# Autodesk Inventor assembly: drivetrain
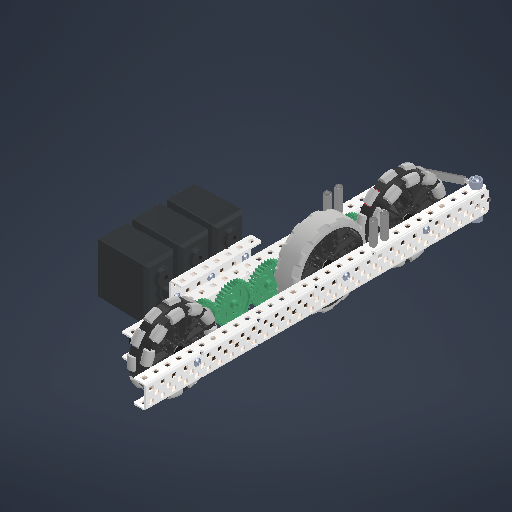
[picture p0: Inventor's stored thumbnail of the model, 512x512]
Saved by Autodesk Inventor 2026.2 (Build 302298000, 298)
## iProperties
Created: 2026-11-04
Part Number: drivetrain
Document SubType Name: Assembly
Designer: BuddyProject
Author: BuddyProject
## Documents named in this file (30)
- E:\593C-CAD-26-27\halfdrivetrain.iam
- E:\VEX-CAD-Inventor-main\Structure\C Channel\Aluminum 1x2x1\Alu C 1x2x1x25.ipt
- E:\VEX-CAD-Inventor-main\Motion\Wheels\Omni Wheel.iam
- E:\VEX-CAD-Inventor-main\Motion\Wheels\Omni Wheel\3.25 Omni AS, No Insert.iam
- E:\VEX-CAD-Inventor-main\Motion\HS Shaft Adapter Circle.ipt
- E:\VEX-CAD-Inventor-main\Motion\Gears\HS Gear.iam
- E:\VEX-CAD-Inventor-main\Motion\Gears\HS Gear\HS 48T Gear, No Insert.iam
- E:\VEX-CAD-Inventor-main\Motion\Wheels\Traction Wheel\3.25 Traction AS, No Insert.iam
- E:\VEX-CAD-Inventor-main\Motion\Wheels\Traction Wheel.iam
- E:\VEX-CAD-Inventor-main\Structure\C Channel\Aluminum 1x2x1\Alu C 1x2x1x30.ipt
- E:\593C-CAD-26-27\dtmotorsub.iam
- E:\VEX-CAD-Inventor-main\Structure\Standoff\Standoff 1.00.ipt
- D:\VEX-CAD-Inventor-main\Structure\Standoff.ipt
- E:\VEX-CAD-Inventor-main\Motion\Shaft LS\Bearing Flat - Shaved.ipt
- E:\593C-CAD-26-27\ModifiedComponents\Bearing Flat - ShavedCut.ipt
- E:\VEX-CAD-Inventor-main\Motion\Shaft LS\Bearing Flat.ipt
- E:\VEX-CAD-Inventor-main\Structure\Hardware\Screw Steel - Star\SScrew Star Threaded 2.500.ipt
- D:\VEX-CAD-Inventor-main\Structure\Hardware\Screw Steel - Star.ipt
- D:\VEX-CAD-Inventor-main\Motion\Spacers\Spacer Nylon .375 OD.ipt
- E:\VEX-CAD-Inventor-main\Motion\Spacers\Spacer Nylon .375 OD\NSpacer .375 OD x .500.ipt
- E:\VEX-CAD-Inventor-main\Motion\Spacers\Washer Steel\SWasher .375 OD x .031250.ipt
- D:\VEX-CAD-Inventor-main\Motion\Spacers\Washer Steel.ipt
- E:\VEX-CAD-Inventor-main\Motion\Spacers\Spacer Nylon .375 OD\NSpacer .375 OD x .125.ipt
- E:\VEX-CAD-Inventor-main\Motion\Spacers\Spacer Nylon .375 OD\NSpacer .375 OD x .250.ipt
- E:\VEX-CAD-Inventor-main\Motion\Gears\LS 36T Gear.ipt
- E:\VEX-CAD-Inventor-main\Motion\Shaft LS\Shaft Collar Metal\Shaft Collar No Screw.ipt
- E:\VEX-CAD-Inventor-main\Structure\Hardware\Coupler\Coupler Star 1.ipt
- D:\VEX-CAD-Inventor-main\Structure\Hardware\Coupler.ipt
- E:\VEX-CAD-Inventor-main\Structure\Standoff\Standoff 1.50.ipt
- E:\VEX-CAD-Inventor-main\Structure\Hardware\Screw Steel - Star\SScrew Star Smooth .500.ipt
## Components (73 placed, 21 different names)
1. 3.25 Omni AS, No Insert:1 [sub-assembly] — Mate:1, Mate:2, Mate:5, Mate:96, Mate:129
2. HS Shaft Adapter Circle:1 — Mate:1, Mate:2, Mate:4
3. HS 48T Gear, No Insert:1 [sub-assembly] — Mate:3, Flush:1, Mate:5, Mate:98, Rotation:3, Mate:129
4. HS Shaft Adapter Circle:2 — Mate:3, Flush:1, Mate:4, Mate:95
5. 3.25 Omni AS, No Insert:2 [sub-assembly] — Mate:76, Mate:131
6. HS Shaft Adapter Circle:3 — Mate:75
7. HS 48T Gear, No Insert:2 [sub-assembly] — Mate:78, Mate:131, Rotation:6
8. HS Shaft Adapter Circle:4
9. 3.25 Traction AS, No Insert:1 [sub-assembly] — Mate:11, Flush:3, Mate:14, Mate:94, Mate:130
10. HS Shaft Adapter Circle:5 — Mate:11, Flush:3, Mate:13
11. HS 48T Gear, No Insert:3 [sub-assembly] — Mate:14, Mate:100, Mate:130, Rotation:4, Rotation:5
12. HS Shaft Adapter Circle:6 — Mate:13, Mate:93
13. Alu C 1x2x1x25:1 — Mate:23, Mate:27, Mate:28, Mate:29, Mate:30, Mate:31, Mate:32, Mate:33, Mate:34, Mate:35, Mate:36, Mate:37, Mate:38, Mate:39, Mate:40, Mate:41, Mate:42, Mate:43, Mate:44, Mate:45, Mate:46, Mate:58, Mate:116, Mate:124, Mate:125, Mate:126, Mate:127, Mate:128, Mate:132, Mate:133, Mate:144, Mate:162, Mate:164
14. Alu C 1x2x1x30:1 — Mate:24, Mate:25, Mate:26, Mate:50, Mate:51, Mate:52, Mate:53, Mate:54, Mate:55, Mate:56, Mate:57, Mate:59, Mate:60, Mate:61, Mate:62, Mate:63, Mate:64, Mate:66, Mate:68, Mate:70, Mate:140, Mate:141, Mate:161, Mate:163
15. dtmotorsub:1 [sub-assembly] — Mate:109, Mate:121, Mate:122
16. Standoff 1.00:1 — Mate:25
17. Standoff 1.00:2 — Mate:23, Mate:28
18. Standoff 1.00:4 — Mate:26
19. Standoff 1.00:5 — Mate:24, Mate:27
20. Bearing Flat - Shaved:1 — Mate:29, Mate:30, Mate:31
21. Bearing Flat - Shaved:2 — Mate:32, Mate:33, Mate:34
22. Bearing Flat - ShavedCut:1 — Mate:35, Mate:36, Mate:37
23. Bearing Flat:1 — Mate:38, Mate:39, Mate:40
24. Bearing Flat:2 — Mate:41, Mate:42, Mate:43, Mate:123
25. Bearing Flat:3 — Mate:44, Mate:45, Mate:46, Mate:103, Mate:104
26. Bearing Flat - Shaved:3 — Mate:50, Mate:51, Mate:52, Mate:65, Mate:72
27. Bearing Flat:5 — Mate:61, Mate:62
28. Bearing Flat - Shaved:4 — Mate:53, Mate:54, Mate:67, Mate:87
29. Bearing Flat:6 — Mate:63, Mate:64
30. Bearing Flat:7 — Mate:57, Mate:58, Mate:101, Mate:102, Mate:116
31. Bearing Flat:8 — Mate:59, Mate:60
32. Bearing Flat - Shaved:5 — Mate:55, Mate:56, Mate:69, Mate:88
33. SScrew Star Threaded 2.500:1 — Mate:65, Mate:66, Mate:71, Mate:73, Mate:75, Mate:77, Mate:79
34. SScrew Star Threaded 2.500:2 — Mate:69, Mate:70, Mate:86, Mate:95, Mate:97
35. SScrew Star Threaded 2.500:3 — Mate:67, Mate:68, Mate:85, Mate:93, Mate:99
36. NSpacer .375 OD x .500:2 — Mate:71, Mate:72, Mate:74
37. SWasher .375 OD x .031250:1 — Mate:73, Mate:74, Mate:76
38. NSpacer .375 OD x .125:3 — Mate:77, Mate:78, Mate:80
39. SWasher .375 OD x .031250:2 — Mate:79, Mate:80
40. NSpacer .375 OD x .500:4 — Mate:82, Mate:85, Mate:87
41. SWasher .375 OD x .031250:3 — Mate:82, Mate:94
42. NSpacer .375 OD x .500:5 — Mate:86, Mate:88
43. SWasher .375 OD x .031250:4 — Mate:96
44. NSpacer .375 OD x .125:6 — Mate:90, Mate:99, Mate:100
45. SWasher .375 OD x .031250:5 — Mate:90
46. NSpacer .375 OD x .125:7 — Mate:97, Mate:98
47. SWasher .375 OD x .031250:6
48. NSpacer .375 OD x .250:8 — Mate:103, Mate:104, Mate:107, Mate:108, Mate:114, Mate:119, Mate:122
49. NSpacer .375 OD x .250:9 — Mate:101, Mate:102, Mate:105, Mate:106, Mate:112, Mate:118
50. SWasher .375 OD x .031250:7 — Mate:105, Mate:106, Mate:111
51. SWasher .375 OD x .031250:8 — Mate:107, Mate:108, Mate:113
52. SWasher .375 OD x .031250:9 — Mate:111, Mate:112, Mate:117
53. SWasher .375 OD x .031250:10 — Mate:113, Mate:114, Mate:120
54. SWasher .375 OD x .031250:11 — Mate:117, Mate:118, Mate:109, Mate:121
55. SWasher .375 OD x .031250:12 — Mate:119, Mate:120
56. LS 36T Gear:1 — Mate:123, Mate:124, Rotation:1, Rotation:3
57. LS 36T Gear:2 — Mate:127, Mate:128, Rotation:2, Rotation:4
58. LS 36T Gear:3 — Mate:132, Mate:133, Rotation:5, Rotation:6
59. LS 36T Gear:4 — Mate:125, Mate:126, Rotation:1, Rotation:2
60. Shaft Collar No Screw:1 — Mate:134, Mate:135, Mate:145, Mate:146
61. Coupler Star 1:1 — Mate:134, Mate:135, Mate:148
62. Standoff 1.50:6 — Mate:147, Mate:148, Mate:149
63. Shaft Collar No Screw:2 — Mate:141, Mate:142, Mate:143, Mate:149
64. Coupler Star 1:2 — Mate:147
65. SScrew Star Smooth .500:4 — Mate:140, Mate:142, Mate:143
66. SScrew Star Smooth .500:6 — Mate:144, Mate:145, Mate:146
67. Shaft Collar No Screw:3 — Mate:162
68. Coupler Star 1:3
69. Standoff 1.50:7
70. Shaft Collar No Screw:4 — Mate:161
71. Coupler Star 1:4
72. SScrew Star Smooth .500:7 — Mate:163
73. SScrew Star Smooth .500:8 — Mate:164
## Relationships (159: Mate 149, RelateRotation 6, Flush 4)
- Mate:1: 3.25 Omni AS, No Insert:1 ↔ HS Shaft Adapter Circle:1
- Mate:2: 3.25 Omni AS, No Insert:1 ↔ HS Shaft Adapter Circle:1
- Mate:3: HS 48T Gear, No Insert:1 ↔ HS Shaft Adapter Circle:2
- Flush:1: HS 48T Gear, No Insert:1 ↔ HS Shaft Adapter Circle:2
- Mate:4: HS Shaft Adapter Circle:1 ↔ HS Shaft Adapter Circle:2
- Mate:5: 3.25 Omni AS, No Insert:1 ↔ HS 48T Gear, No Insert:1
- [Mate]: 3.25 Omni AS, No Insert:2 ↔ HS Shaft Adapter Circle:3
- [Mate]: 3.25 Omni AS, No Insert:2 ↔ HS Shaft Adapter Circle:3
- [Mate]: HS 48T Gear, No Insert:2 ↔ HS Shaft Adapter Circle:4
- [Flush]: HS 48T Gear, No Insert:2 ↔ HS Shaft Adapter Circle:4
- [Mate]: HS Shaft Adapter Circle:3 ↔ HS Shaft Adapter Circle:4
- [Mate]: 3.25 Omni AS, No Insert:2 ↔ HS 48T Gear, No Insert:2
- Mate:11: 3.25 Traction AS, No Insert:1 ↔ HS Shaft Adapter Circle:5
- Flush:3: 3.25 Traction AS, No Insert:1 ↔ HS Shaft Adapter Circle:5
- [Mate]: HS 48T Gear, No Insert:3 ↔ HS Shaft Adapter Circle:6
- [Flush]: HS 48T Gear, No Insert:3 ↔ HS Shaft Adapter Circle:6
- Mate:13: HS Shaft Adapter Circle:5 ↔ HS Shaft Adapter Circle:6
- Mate:14: 3.25 Traction AS, No Insert:1 ↔ HS 48T Gear, No Insert:3
- Mate:23: Alu C 1x2x1x25:1 ↔ Standoff 1.00:2
- Mate:24: Alu C 1x2x1x30:1 ↔ Standoff 1.00:5
- Mate:25: Alu C 1x2x1x30:1 ↔ Standoff 1.00:1
- Mate:26: Alu C 1x2x1x30:1 ↔ Standoff 1.00:4
- Mate:27: Alu C 1x2x1x25:1 ↔ Standoff 1.00:5
- Mate:28: Alu C 1x2x1x25:1 ↔ Standoff 1.00:2
- Mate:29: Alu C 1x2x1x25:1 ↔ Bearing Flat - Shaved:1
- Mate:30: Alu C 1x2x1x25:1 ↔ Bearing Flat - Shaved:1
- Mate:31: Alu C 1x2x1x25:1 ↔ Bearing Flat - Shaved:1
- Mate:32: Alu C 1x2x1x25:1 ↔ Bearing Flat - Shaved:2
- Mate:33: Alu C 1x2x1x25:1 ↔ Bearing Flat - Shaved:2
- Mate:34: Alu C 1x2x1x25:1 ↔ Bearing Flat - Shaved:2
- Mate:35: Alu C 1x2x1x25:1 ↔ Bearing Flat - ShavedCut:1
- Mate:36: Alu C 1x2x1x25:1 ↔ Bearing Flat - ShavedCut:1
- Mate:37: Alu C 1x2x1x25:1 ↔ Bearing Flat - ShavedCut:1
- Mate:38: Alu C 1x2x1x25:1 ↔ Bearing Flat:1
- Mate:39: Alu C 1x2x1x25:1 ↔ Bearing Flat:1
- Mate:40: Alu C 1x2x1x25:1 ↔ Bearing Flat:1
- Mate:41: Alu C 1x2x1x25:1 ↔ Bearing Flat:2
- Mate:42: Alu C 1x2x1x25:1 ↔ Bearing Flat:2
- Mate:43: Alu C 1x2x1x25:1 ↔ Bearing Flat:2
- Mate:44: Alu C 1x2x1x25:1 ↔ Bearing Flat:3
- Mate:45: Alu C 1x2x1x25:1 ↔ Bearing Flat:3
- Mate:46: Alu C 1x2x1x25:1 ↔ Bearing Flat:3
- Mate:50: Alu C 1x2x1x30:1 ↔ Bearing Flat - Shaved:3
- Mate:51: Alu C 1x2x1x30:1 ↔ Bearing Flat - Shaved:3
- Mate:52: Alu C 1x2x1x30:1 ↔ Bearing Flat - Shaved:3
- Mate:53: Alu C 1x2x1x30:1 ↔ Bearing Flat - Shaved:4
- Mate:54: Alu C 1x2x1x30:1 ↔ Bearing Flat - Shaved:4
- Mate:55: Alu C 1x2x1x30:1 ↔ Bearing Flat - Shaved:5
- Mate:56: Alu C 1x2x1x30:1 ↔ Bearing Flat - Shaved:5
- Mate:57: Alu C 1x2x1x30:1 ↔ Bearing Flat:7
- Mate:58: Alu C 1x2x1x25:1 ↔ Bearing Flat:7
- Mate:59: Alu C 1x2x1x30:1 ↔ Bearing Flat:8
- Mate:60: Alu C 1x2x1x30:1 ↔ Bearing Flat:8
- Mate:61: Alu C 1x2x1x30:1 ↔ Bearing Flat:5
- Mate:62: Alu C 1x2x1x30:1 ↔ Bearing Flat:5
- Mate:63: Alu C 1x2x1x30:1 ↔ Bearing Flat:6
- Mate:64: Alu C 1x2x1x30:1 ↔ Bearing Flat:6
- Mate:65: Bearing Flat - Shaved:3 ↔ SScrew Star Threaded 2.500:1
- Mate:66: Alu C 1x2x1x30:1 ↔ SScrew Star Threaded 2.500:1
- Mate:67: Bearing Flat - Shaved:4 ↔ SScrew Star Threaded 2.500:3
- Mate:68: Alu C 1x2x1x30:1 ↔ SScrew Star Threaded 2.500:3
- Mate:69: Bearing Flat - Shaved:5 ↔ SScrew Star Threaded 2.500:2
- Mate:70: Alu C 1x2x1x30:1 ↔ SScrew Star Threaded 2.500:2
- Mate:71: SScrew Star Threaded 2.500:1 ↔ NSpacer .375 OD x .500:2
- Mate:72: Bearing Flat - Shaved:3 ↔ NSpacer .375 OD x .500:2
- Mate:73: SScrew Star Threaded 2.500:1 ↔ SWasher .375 OD x .031250:1
- Mate:74: NSpacer .375 OD x .500:2 ↔ SWasher .375 OD x .031250:1
- Mate:75: HS Shaft Adapter Circle:3 ↔ SScrew Star Threaded 2.500:1
- Mate:76: 3.25 Omni AS, No Insert:2 ↔ SWasher .375 OD x .031250:1
- Mate:77: SScrew Star Threaded 2.500:1 ↔ NSpacer .375 OD x .125:3
- Mate:78: HS 48T Gear, No Insert:2 ↔ NSpacer .375 OD x .125:3
- Mate:79: SScrew Star Threaded 2.500:1 ↔ SWasher .375 OD x .031250:2
- Mate:80: NSpacer .375 OD x .125:3 ↔ SWasher .375 OD x .031250:2
- [Mate]: NSpacer .375 OD x .500:4 ↔ SWasher .375 OD x .031250:3
- Mate:82: NSpacer .375 OD x .500:4 ↔ SWasher .375 OD x .031250:3
- [Mate]: NSpacer .375 OD x .500:5 ↔ SWasher .375 OD x .031250:4
- [Mate]: NSpacer .375 OD x .500:5 ↔ SWasher .375 OD x .031250:4
- Mate:85: SScrew Star Threaded 2.500:3 ↔ NSpacer .375 OD x .500:4
- Mate:86: SScrew Star Threaded 2.500:2 ↔ NSpacer .375 OD x .500:5
- Mate:87: Bearing Flat - Shaved:4 ↔ NSpacer .375 OD x .500:4
- Mate:88: Bearing Flat - Shaved:5 ↔ NSpacer .375 OD x .500:5
- [Mate]: NSpacer .375 OD x .125:6 ↔ SWasher .375 OD x .031250:5
- Mate:90: NSpacer .375 OD x .125:6 ↔ SWasher .375 OD x .031250:5
- [Mate]: NSpacer .375 OD x .125:7 ↔ SWasher .375 OD x .031250:6
- [Mate]: NSpacer .375 OD x .125:7 ↔ SWasher .375 OD x .031250:6
- Mate:93: HS Shaft Adapter Circle:6 ↔ SScrew Star Threaded 2.500:3
- Mate:94: 3.25 Traction AS, No Insert:1 ↔ SWasher .375 OD x .031250:3
- Mate:95: HS Shaft Adapter Circle:2 ↔ SScrew Star Threaded 2.500:2
- Mate:96: 3.25 Omni AS, No Insert:1 ↔ SWasher .375 OD x .031250:4
- Mate:97: SScrew Star Threaded 2.500:2 ↔ NSpacer .375 OD x .125:7
- Mate:98: HS 48T Gear, No Insert:1 ↔ NSpacer .375 OD x .125:7
- Mate:99: SScrew Star Threaded 2.500:3 ↔ NSpacer .375 OD x .125:6
- Mate:100: HS 48T Gear, No Insert:3 ↔ NSpacer .375 OD x .125:6
- Mate:101: Bearing Flat:7 ↔ NSpacer .375 OD x .250:9
- Mate:102: Bearing Flat:7 ↔ NSpacer .375 OD x .250:9
- Mate:103: Bearing Flat:3 ↔ NSpacer .375 OD x .250:8
- Mate:104: Bearing Flat:3 ↔ NSpacer .375 OD x .250:8
- Mate:105: NSpacer .375 OD x .250:9 ↔ SWasher .375 OD x .031250:7
- Mate:106: NSpacer .375 OD x .250:9 ↔ SWasher .375 OD x .031250:7
- Mate:107: NSpacer .375 OD x .250:8 ↔ SWasher .375 OD x .031250:8
- Mate:108: NSpacer .375 OD x .250:8 ↔ SWasher .375 OD x .031250:8
- Mate:109: dtmotorsub:1 ↔ SWasher .375 OD x .031250:11
- Mate:111: SWasher .375 OD x .031250:7 ↔ SWasher .375 OD x .031250:9
- Mate:112: NSpacer .375 OD x .250:9 ↔ SWasher .375 OD x .031250:9
- Mate:113: SWasher .375 OD x .031250:8 ↔ SWasher .375 OD x .031250:10
- Mate:114: NSpacer .375 OD x .250:8 ↔ SWasher .375 OD x .031250:10
- Mate:116: Alu C 1x2x1x25:1 ↔ Bearing Flat:7
- Mate:117: SWasher .375 OD x .031250:9 ↔ SWasher .375 OD x .031250:11
- Mate:118: NSpacer .375 OD x .250:9 ↔ SWasher .375 OD x .031250:11
- Mate:119: NSpacer .375 OD x .250:8 ↔ SWasher .375 OD x .031250:12
- Mate:120: SWasher .375 OD x .031250:10 ↔ SWasher .375 OD x .031250:12
- Mate:121: dtmotorsub:1 ↔ SWasher .375 OD x .031250:11
- Mate:122: dtmotorsub:1 ↔ NSpacer .375 OD x .250:8
- Mate:123: Bearing Flat:2 ↔ LS 36T Gear:1
- Mate:124 (2.54 mm): Alu C 1x2x1x25:1 ↔ LS 36T Gear:1
- Mate:125: Alu C 1x2x1x25:1 ↔ LS 36T Gear:4
- Mate:126 (2.54 mm): Alu C 1x2x1x25:1 ↔ LS 36T Gear:4
- Mate:127: Alu C 1x2x1x25:1 ↔ LS 36T Gear:2
- Mate:128 (2.54 mm): Alu C 1x2x1x25:1 ↔ LS 36T Gear:2
- Rotation:1 [RelateRotation] (1 ul): LS 36T Gear:1 ↔ LS 36T Gear:4
- Rotation:2 [RelateRotation] (1 ul): LS 36T Gear:2 ↔ LS 36T Gear:4
- Rotation:3 [RelateRotation] (1.6667 ul): HS 48T Gear, No Insert:1 ↔ LS 36T Gear:1
- Mate:129: 3.25 Omni AS, No Insert:1 ↔ HS 48T Gear, No Insert:1
- Mate:130: 3.25 Traction AS, No Insert:1 ↔ HS 48T Gear, No Insert:3
- Mate:131: 3.25 Omni AS, No Insert:2 ↔ HS 48T Gear, No Insert:2
- Rotation:4 [RelateRotation] (1.6667 ul): HS 48T Gear, No Insert:3 ↔ LS 36T Gear:2
- Mate:132: Alu C 1x2x1x25:1 ↔ LS 36T Gear:3
- Mate:133 (2.54 mm): Alu C 1x2x1x25:1 ↔ LS 36T Gear:3
- Rotation:5 [RelateRotation] (1.6667 ul): HS 48T Gear, No Insert:3 ↔ LS 36T Gear:3
- Rotation:6 [RelateRotation] (1.6667 ul): HS 48T Gear, No Insert:2 ↔ LS 36T Gear:3
- Mate:134: Shaft Collar No Screw:1 ↔ Coupler Star 1:1
- Mate:135: Shaft Collar No Screw:1 ↔ Coupler Star 1:1
- [Mate]: Shaft Collar No Screw:2 ↔ Coupler Star 1:2
- [Mate]: Shaft Collar No Screw:2 ↔ Coupler Star 1:2
- Mate:140: Alu C 1x2x1x30:1 ↔ SScrew Star Smooth .500:4
- Mate:141: Alu C 1x2x1x30:1 ↔ Shaft Collar No Screw:2
- Mate:142: Shaft Collar No Screw:2 ↔ SScrew Star Smooth .500:4
- Mate:143: Shaft Collar No Screw:2 ↔ SScrew Star Smooth .500:4
- Mate:144: Alu C 1x2x1x25:1 ↔ SScrew Star Smooth .500:6
- Mate:145: Shaft Collar No Screw:1 ↔ SScrew Star Smooth .500:6
- Mate:146: Shaft Collar No Screw:1 ↔ SScrew Star Smooth .500:6
- Mate:147: Standoff 1.50:6 ↔ Coupler Star 1:2
- Mate:148: Coupler Star 1:1 ↔ Standoff 1.50:6
- Mate:149 (9.3472 mm): Standoff 1.50:6 ↔ Shaft Collar No Screw:2
- [Mate]: Shaft Collar No Screw:3 ↔ Coupler Star 1:3
- [Mate]: Shaft Collar No Screw:3 ↔ Coupler Star 1:3
- [Mate]: Shaft Collar No Screw:4 ↔ Coupler Star 1:4
- [Mate]: Shaft Collar No Screw:4 ↔ Coupler Star 1:4
- [Mate]: Shaft Collar No Screw:4 ↔ SScrew Star Smooth .500:7
- [Mate]: Shaft Collar No Screw:4 ↔ SScrew Star Smooth .500:7
- [Mate]: Shaft Collar No Screw:3 ↔ SScrew Star Smooth .500:8
- [Mate]: Shaft Collar No Screw:3 ↔ SScrew Star Smooth .500:8
- [Mate]: Standoff 1.50:7 ↔ Coupler Star 1:4
- [Mate]: Coupler Star 1:3 ↔ Standoff 1.50:7
- [Mate] (9.3472 mm): Standoff 1.50:7 ↔ Shaft Collar No Screw:4
- Mate:161: Alu C 1x2x1x30:1 ↔ Shaft Collar No Screw:4
- Mate:162: Alu C 1x2x1x25:1 ↔ Shaft Collar No Screw:3
- Mate:163: Alu C 1x2x1x30:1 ↔ SScrew Star Smooth .500:7
- Mate:164: Alu C 1x2x1x25:1 ↔ SScrew Star Smooth .500:8
## Named parameters: d6_d0 = 0 mm, d7_d1 = 0 mm, d8_d2 = 0 mm, d9_d3 = 0 mm, d10_d4 = 0 mm, d11_d5 = 0 mm, d14_d2 = 0 mm, d15_d3 = 0 mm, d98_d91 = 0 mm, d100_d98_d91 = 0 mm, d101_d99 = 0 mm, d106_d97 = 0 mm, d108_d106_d97 = 0 mm, d109_d107 = 0 mm, d162_d160 = 0 mm, d163_d161 = 0 mm, d176_d168 = 0 mm, d177_d169 = 0 mm, d178_d171 = 0 mm, d179_d172 = 0 mm, d180_d173 = 0 mm, d181_d174 = 0 mm, d182_d175 = 9.3472 mm, d183_d160 = 0 mm, d184_d161 = 0 mm, d185_d162_d160 = 0 mm, d186_d163_d161 = 0 mm
